# Autodesk Inventor assembly: 4861 TP-744x1244x42
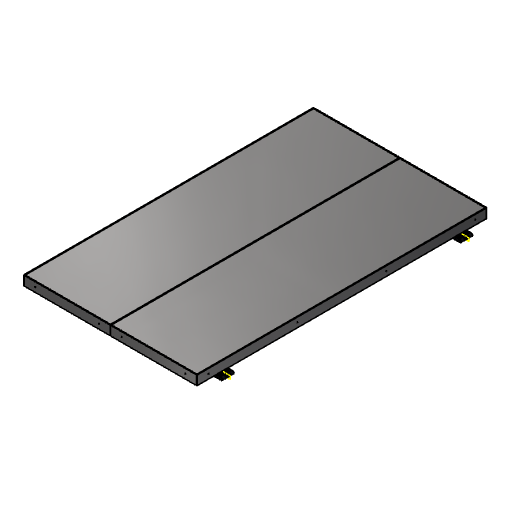
[picture p0: Inventor's stored thumbnail of the model, 512x512]
Saved by Autodesk Inventor 2024.3 (Build 283343000, 343)
## iProperties
RuleStatus: InUse
Created: 2019-06-24
Part Number: 4861 TP-744x1244x42
Material: Generisch
Document SubType Name: Assembly
Designer: MK
Mass: 18732.2 g
Surface Area: 46751.2 cm^2
Volume: 2545.12 cm^3
Density: 7.36003 g/cm^3
Description: Tür-Paneel
InventorSizerSetup: TP 2
Author: MK
## Documents named in this file (5)
- C:\Users\la\Documents\GitHub\Inventor_Sizer\C# Version\GR\Einzelteile\4861 TP-744x1244x42.iam
- C:\Users\la\Documents\GitHub\Inventor_Sizer\C# Version\MODELS\Scharnier.iam
- C:\Users\la\Documents\GitHub\Inventor_Sizer\C# Version\MODELS\Türgriff abschließbar.iam
- C:\Users\la\Documents\GitHub\Inventor_Sizer\C# Version\GR\Einzelteile\4861 744x1244x42-Au.ipt
- C:\Users\la\Documents\GitHub\Inventor_Sizer\C# Version\GR\Einzelteile\4861 744x1244x42-In-2T.ipt
## Components (7 placed, 4 different names)
1. 4861 744x1244x42-Au:1 — Mate:6, Mate:7, Mate:8, Mate:9, Mate:10, Mate:11, Mate:12
2. Türgriff abschließbar:4 [sub-assembly] — Mate:9, Mate:10, Mate:11
3. Türgriff abschließbar:5 [sub-assembly]
4. Scharnier:2 [sub-assembly] — Mate:12
5. Scharnier:3 [sub-assembly]
6. 4861 744x1244x42-In-2T:1 — Mate:6, Mate:7, Mate:8
7. 4861 744x1244x42-In-2T:2
## Component patterns: (2 elements, first: Türgriff abschließbar:4), (2 elements, first: Scharnier:2), (2 elements, first: 4861 744x1244x42-In-2T:1)
## Relationships (7: Mate 7)
- Mate:6: 4861 744x1244x42-Au:1 ↔ 4861 744x1244x42-In-2T:1
- Mate:7 (0.5 mm): 4861 744x1244x42-Au:1 ↔ 4861 744x1244x42-In-2T:1
- Mate:8 (0.5 mm): 4861 744x1244x42-Au:1 ↔ 4861 744x1244x42-In-2T:1
- Mate:9: 4861 744x1244x42-Au:1 ↔ Türgriff abschließbar:4
- Mate:10: 4861 744x1244x42-Au:1 ↔ Türgriff abschließbar:4
- Mate:11: 4861 744x1244x42-Au:1 ↔ Türgriff abschließbar:4
- Mate:12: 4861 744x1244x42-Au:1 ↔ Scharnier:2
## Named parameters: Clearance = 0.5 mm, InSplit = 2, InWidth = 370.5 mm, HingeCount = 2, HingePitch = 1024 mm, HandleCount = 2, HandlePitch = 844 mm, Length = 1244 mm, Width = 744 mm, HingeEdge = 100 mm, HingeSpan = 24 mm, HandleEdge = 160 mm, HandleSpan = 78 mm
